# Autodesk Inventor assembly: cu totul
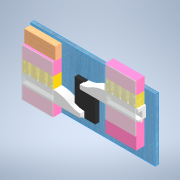
[picture p0: Inventor's stored thumbnail of the model, 180x180]
Saved by Autodesk Inventor 2020 (Build 240168000, 168)
## iProperties
Created: 2022-06-19
Part Number: cu totul
Document SubType Name: Assembly
Designer: drago
Author: drago
## Documents named in this file (9)
- C:\Users\drago\Documents\ULTIMA_VARIANTA\cu totul.iam
- C:\Users\drago\Documents\ULTIMA_VARIANTA\Placas_spate.ipt
- C:\Users\drago\Documents\ULTIMA_VARIANTA\Suporti Cuie\Suport Cuie Varianta 1 + PDF pt DAN sa faca cheile\P1_V1_001.ipt
- C:\Users\drago\Documents\ULTIMA_VARIANTA\Suporti Cuie\Suport Cuie Varianta 3 + PDF pt DAN sa faca cheile - Copy (3)\P1_V3_001.ipt
- C:\Users\drago\Documents\ULTIMA_VARIANTA\Broasca\Broascav1\P2_V1_001.ipt
- C:\Users\drago\Documents\ULTIMA_VARIANTA\Broasca\Broascav3\P2_V3_001.ipt
- C:\Users\drago\Documents\ULTIMA_VARIANTA\lemn_deasupra_suport_cuie.ipt
- C:\Users\drago\Documents\ULTIMA_VARIANTA\crucea.ipt
- C:\Users\drago\Documents\ULTIMA_VARIANTA\plexi.ipt
## Components (14 placed, 8 different names)
1. Placas_spate:1 — Mate:1, Mate:2, Mate:3, Mate:4, Mate:11, Mate:12, Mate:14, Mate:16, Flush:12, Flush:13, Mate:24
2. P1_V1_001:1 — Mate:1, Planar:1, Mate:10, Flush:1, Mate:15
3. P1_V3_001:1 — Mate:2, Mate:13, Flush:2, Planar:2, Mate:17, Flush:4
4. P2_V1_001:1 — Mate:4, Planar:2
5. P2_V3_001:1 — Mate:3, Planar:1
6. lemn_deasupra_suport_cuie:1 — Mate:10, Mate:11, Flush:1, Flush:3, Mate:20, Flush:8, Flush:9, Mate:25, Flush:15
7. crucea:1
8. lemn_deasupra_suport_cuie:2 — Mate:12, Mate:13, Flush:2, Mate:21, Flush:10, Flush:11
9. lemn_deasupra_suport_cuie:3 — Mate:14, Mate:15, Flush:3, Flush:12, Flush:13
10. lemn_deasupra_suport_cuie:4 — Mate:16, Mate:17, Flush:4, Mate:23, Flush:14
11. plexi:1 — Mate:21, Flush:10, Flush:11
12. plexi:2 — Mate:20, Flush:8, Flush:9
13. lemn_deasupra_suport_cuie:5 — Mate:25, Flush:15
14. lemn_deasupra_suport_cuie:6 — Mate:23, Mate:24, Flush:14
## Relationships (31: Mate 17, Flush 12, PlanarJoint 2)
- Mate:1: Placas_spate:1 ↔ P1_V1_001:1
- Mate:2: Placas_spate:1 ↔ P1_V3_001:1
- Mate:3: Placas_spate:1 ↔ P2_V3_001:1
- Mate:4: Placas_spate:1 ↔ P2_V1_001:1
- Planar:1: P1_V1_001:1 ↔ P2_V3_001:1
- Mate:10: P1_V1_001:1 ↔ lemn_deasupra_suport_cuie:1
- Mate:11: Placas_spate:1 ↔ lemn_deasupra_suport_cuie:1
- Flush:1: P1_V1_001:1 ↔ lemn_deasupra_suport_cuie:1
- Mate:12: Placas_spate:1 ↔ lemn_deasupra_suport_cuie:2
- Mate:13: P1_V3_001:1 ↔ lemn_deasupra_suport_cuie:2
- Flush:2: P1_V3_001:1 ↔ lemn_deasupra_suport_cuie:2
- Mate:14: Placas_spate:1 ↔ lemn_deasupra_suport_cuie:3
- Mate:15 (55 mm): P1_V1_001:1 ↔ lemn_deasupra_suport_cuie:3
- Flush:3: lemn_deasupra_suport_cuie:1 ↔ lemn_deasupra_suport_cuie:3
- Planar:2: P1_V3_001:1 ↔ P2_V1_001:1
- Mate:16: Placas_spate:1 ↔ lemn_deasupra_suport_cuie:4
- Mate:17 (55 mm): P1_V3_001:1 ↔ lemn_deasupra_suport_cuie:4
- Flush:4: P1_V3_001:1 ↔ lemn_deasupra_suport_cuie:4
- Mate:20: lemn_deasupra_suport_cuie:1 ↔ plexi:2
- Flush:8: lemn_deasupra_suport_cuie:1 ↔ plexi:2
- Flush:9: lemn_deasupra_suport_cuie:1 ↔ plexi:2
- Mate:21: lemn_deasupra_suport_cuie:2 ↔ plexi:1
- Flush:10: lemn_deasupra_suport_cuie:2 ↔ plexi:1
- Flush:11: lemn_deasupra_suport_cuie:2 ↔ plexi:1
- Flush:12: Placas_spate:1 ↔ lemn_deasupra_suport_cuie:3
- Flush:13: Placas_spate:1 ↔ lemn_deasupra_suport_cuie:3
- Mate:23: lemn_deasupra_suport_cuie:4 ↔ lemn_deasupra_suport_cuie:6
- Mate:24: Placas_spate:1 ↔ lemn_deasupra_suport_cuie:6
- Flush:14: lemn_deasupra_suport_cuie:4 ↔ lemn_deasupra_suport_cuie:6
- Mate:25: lemn_deasupra_suport_cuie:1 ↔ lemn_deasupra_suport_cuie:5
- Flush:15: lemn_deasupra_suport_cuie:1 ↔ lemn_deasupra_suport_cuie:5
